# Autodesk Inventor assembly: Pinball_Alabama_SNF
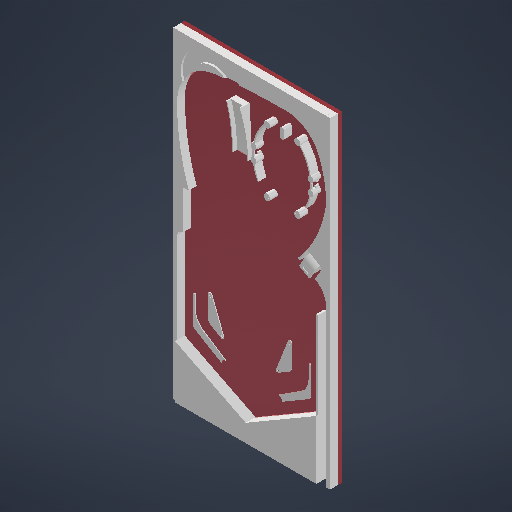
[picture p0: Inventor's stored thumbnail of the model, 512x512]
Saved by Autodesk Inventor 2026 (Build 300175000, 175)
## iProperties
Created: 2026-09-07
Part Number: Pinball_Alabama_SNF
Document SubType Name: Assembly
Designer: joshb
Author: joshb
## Documents named in this file (17)
- C:\Users\joshb\Downloads\Pinball_Alabama_SNF.iam
- C:\Users\joshb\Downloads\Pinball_Playfield.ipt
- C:\Users\joshb\Downloads\Pinball_Right_Slingshot.ipt
- C:\Users\joshb\Downloads\Pinball_LR_Sidewall.ipt
- C:\Users\joshb\Downloads\Pinball_Sleeve.ipt
- C:\Users\joshb\Downloads\Pinball_Left_Slingshot.ipt
- C:\Users\joshb\Downloads\Pinball_Left_Outlane_Guide.ipt
- C:\Users\joshb\Downloads\Pinball_Left_Plunger_Lane.ipt
- C:\Users\joshb\Downloads\Pinball_Right_Outlane_Guide.ipt
- C:\Users\joshb\Downloads\Pinball_BryantDennyStadium.ipt
- C:\Users\joshb\Downloads\Pinball_Ball_Launch_and_Whistle_holder.ipt
- C:\Users\joshb\Downloads\Pinball_Whistle_Scoop.ipt
- C:\Users\joshb\Downloads\Pinball_Top_Right_Loop_Section.ipt
- C:\Users\joshb\Downloads\Pinball_Top_Left_Loop.ipt
- C:\Users\joshb\Downloads\Pinball_Field_Goal_Ramp.ipt
- C:\Users\joshb\Downloads\Pinball_Left_Sidewall.ipt
- C:\Users\joshb\Downloads\Pinball_Middle_Left_Loop.ipt
## Components (16 placed, 16 different names)
1. Pinball_Playfield:1 — Flush:3, Flush:4, Mate:3, Flush:5, Mate:5, Mate:6, Mate:7, Mate:8, Mate:9, Mate:10, Mate:11, Mate:12, Mate:15, Mate:18, Mate:21, Flush:8, Mate:23, Flush:9, Mate:24, Flush:10, Mate:25
2. Pinball_Right_Slingshot:1 — Mate:6
3. Pinball_LR_Sidewall:2 — Flush:3, Flush:4, Mate:3, Angle:1, Mate:13, Mate:14, Mate:19, Mate:20
4. Pinball_Sleeve:1 — Flush:5, Mate:5, Flush:6, Flush:7
5. Pinball_Left_Slingshot:1 — Mate:7
6. Pinball_Left_Outlane_Guide:1 — Mate:8
7. Pinball_Left_Plunger_Lane:1 — Mate:9, Flush:6, Flush:7
8. Pinball_Right_Outlane_Guide:1 — Mate:10
9. Pinball_BryantDennyStadium:1 — Mate:11, Angle:1
10. Pinball_Ball_Launch_and_Whistle_holder:1 — Mate:12, Mate:13, Mate:14, Mate:16, Mate:17
11. Pinball_Whistle_Scoop:1 — Mate:15, Mate:16, Mate:17
12. Pinball_Top_Right_Loop_Section:1 — Mate:18, Mate:19, Mate:20, Mate:22
13. Pinball_Top_Left_Loop:1 — Mate:21, Flush:8, Mate:22, Mate:27
14. Pinball_Field_Goal_Ramp:1 — Mate:23, Mate:28
15. Pinball_Left_Sidewall:1 — Flush:9, Mate:24, Flush:10, Mate:26, Mate:28
16. Pinball_Middle_Left_Loop:1 — Mate:25, Mate:26, Mate:27
## Relationships (34: Mate 25, Flush 8, Angle 1)
- Flush:3: Pinball_Playfield:1 ↔ Pinball_LR_Sidewall:2
- Flush:4: Pinball_Playfield:1 ↔ Pinball_LR_Sidewall:2
- Mate:3: Pinball_Playfield:1 ↔ Pinball_LR_Sidewall:2
- Flush:5: Pinball_Playfield:1 ↔ Pinball_Sleeve:1
- Mate:5: Pinball_Playfield:1 ↔ Pinball_Sleeve:1
- Mate:6: Pinball_Playfield:1 ↔ Pinball_Right_Slingshot:1
- Mate:7: Pinball_Playfield:1 ↔ Pinball_Left_Slingshot:1
- Mate:8: Pinball_Playfield:1 ↔ Pinball_Left_Outlane_Guide:1
- Mate:9: Pinball_Playfield:1 ↔ Pinball_Left_Plunger_Lane:1
- Flush:6: Pinball_Sleeve:1 ↔ Pinball_Left_Plunger_Lane:1
- Flush:7: Pinball_Sleeve:1 ↔ Pinball_Left_Plunger_Lane:1
- Mate:10: Pinball_Playfield:1 ↔ Pinball_Right_Outlane_Guide:1
- Mate:11: Pinball_Playfield:1 ↔ Pinball_BryantDennyStadium:1
- Angle:1 (90 deg): Pinball_LR_Sidewall:2 ↔ Pinball_BryantDennyStadium:1
- Mate:12: Pinball_Playfield:1 ↔ Pinball_Ball_Launch_and_Whistle_holder:1
- Mate:13: Pinball_LR_Sidewall:2 ↔ Pinball_Ball_Launch_and_Whistle_holder:1
- Mate:14: Pinball_LR_Sidewall:2 ↔ Pinball_Ball_Launch_and_Whistle_holder:1
- Mate:15: Pinball_Playfield:1 ↔ Pinball_Whistle_Scoop:1
- Mate:16: Pinball_Ball_Launch_and_Whistle_holder:1 ↔ Pinball_Whistle_Scoop:1
- Mate:17: Pinball_Ball_Launch_and_Whistle_holder:1 ↔ Pinball_Whistle_Scoop:1
- Mate:18: Pinball_Playfield:1 ↔ Pinball_Top_Right_Loop_Section:1
- Mate:19: Pinball_LR_Sidewall:2 ↔ Pinball_Top_Right_Loop_Section:1
- Mate:20: Pinball_LR_Sidewall:2 ↔ Pinball_Top_Right_Loop_Section:1
- Mate:21: Pinball_Playfield:1 ↔ Pinball_Top_Left_Loop:1
- Flush:8: Pinball_Playfield:1 ↔ Pinball_Top_Left_Loop:1
- Mate:22: Pinball_Top_Right_Loop_Section:1 ↔ Pinball_Top_Left_Loop:1
- Mate:23: Pinball_Playfield:1 ↔ Pinball_Field_Goal_Ramp:1
- Flush:9: Pinball_Playfield:1 ↔ Pinball_Left_Sidewall:1
- Mate:24: Pinball_Playfield:1 ↔ Pinball_Left_Sidewall:1
- Flush:10: Pinball_Playfield:1 ↔ Pinball_Left_Sidewall:1
- Mate:25: Pinball_Playfield:1 ↔ Pinball_Middle_Left_Loop:1
- Mate:26: Pinball_Left_Sidewall:1 ↔ Pinball_Middle_Left_Loop:1
- Mate:27: Pinball_Top_Left_Loop:1 ↔ Pinball_Middle_Left_Loop:1
- Mate:28 (165.1 mm): Pinball_Field_Goal_Ramp:1 ↔ Pinball_Left_Sidewall:1
